# Autodesk Inventor assembly: S3케이스
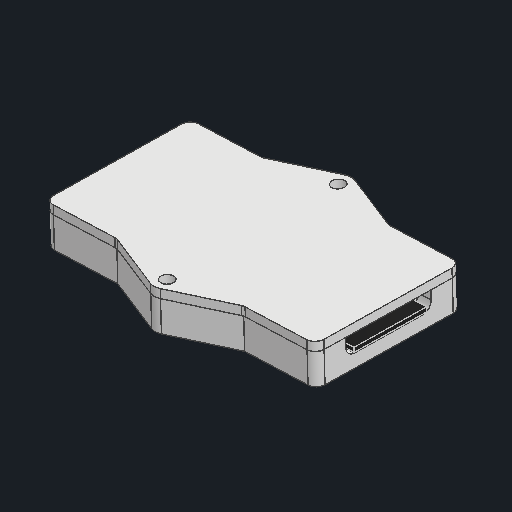
[picture p0: Inventor's stored thumbnail of the model, 512x512]
Saved by Autodesk Inventor 2027 (Build 310192000, 192)
## iProperties
Created: 2026-09-22
Part Number: S3케이스
Document SubType Name: Assembly
Designer: khw
Author: khw
## Documents named in this file (4)
- C:\Users\khw\Desktop\ESP32-S3-WROOM-1 웹서버\S3케이스.iam
- C:\Users\khw\Desktop\ESP32-S3-WROOM-1 웹서버\케이스 - 복사본.ipt
- C:\Users\khw\Desktop\ESP32-S3-WROOM-1 웹서버\케이스.ipt
- C:\Users\khw\Desktop\ESP32-S3-WROOM-1 웹서버\ESP32-S3.ipt
## Components (3 placed, 3 different names)
1. 케이스 - 복사본:1 — 메이트:2, 메이트:3, 메이트:4
2. 케이스:1 — 메이트:1, 각도:1, 메이트:2, 메이트:3, 메이트:4, 메이트:5
3. ESP32-S3:1 — 메이트:1, 각도:1, 메이트:5
## Relationships (6: Mate 5, Angle 1)
- 메이트:1 [Mate]: 케이스:1 ↔ ESP32-S3:1
- 각도:1 [Angle] (0 deg): 케이스:1 ↔ ESP32-S3:1
- 메이트:2 [Mate]: 케이스 - 복사본:1 ↔ 케이스:1
- 메이트:3 [Mate]: 케이스 - 복사본:1 ↔ 케이스:1
- 메이트:4 [Mate]: 케이스 - 복사본:1 ↔ 케이스:1
- 메이트:5 [Mate] (0.5 mm): 케이스:1 ↔ ESP32-S3:1
